# Autodesk Inventor assembly: mecanismo compoleto
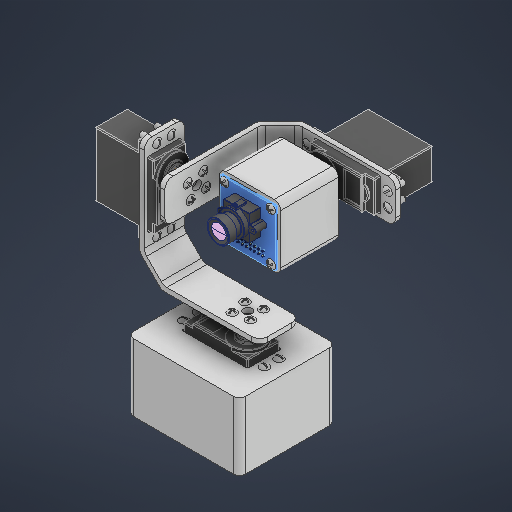
[picture p0: Inventor's stored thumbnail of the model, 512x512]
Saved by Autodesk Inventor 2027.2 (Build 312334000, 334)
## iProperties
Created: 2026-09-12
Part Number: mecanismo compoleto
Document SubType Name: Assembly
Designer: alexa
Project: STAR TRAKCER
Author: alexa
Title: MECANISMO STAR TRACKER
## Documents named in this file (10)
- C:\Users\alexa\tesis-star-tracker\Inventor\Mecanismo_3GDL\Alineacion_R1_20261113\CAD\Gimbal_3GDL_alineado_R1.iam
- C:\Users\alexa\tesis-star-tracker\Inventor\Mecanismo_3GDL\Alineacion_R1_20261113\CAD\base.ipt
- C:\Users\alexa\tesis-star-tracker\Inventor\Mecanismo_3GDL\Alineacion_R1_20261113\CAD\Pieza6.ipt
- C:\Users\alexa\tesis-star-tracker\Inventor\Mecanismo_3GDL\Alineacion_R1_20261113\CAD\Servo MG996R.ipt
- C:\Users\alexa\tesis-star-tracker\Inventor\Mecanismo_3GDL\Alineacion_R1_20261113\CAD\210212-3x5.ipt
- C:\Users\alexa\tesis-star-tracker\Inventor\Mecanismo_3GDL\Alineacion_R1_20261113\CAD\Base_Z.ipt
- C:\Users\alexa\tesis-star-tracker\Inventor\Mecanismo_3GDL\Alineacion_R1_20261113\CAD\Camera OV7670.ipt
- C:\Users\alexa\tesis-star-tracker\Inventor\Mecanismo_3GDL\Alineacion_R1_20261113\CAD\cajita.ipt
- C:\Users\alexa\tesis-star-tracker\Inventor\Mecanismo_3GDL\Alineacion_R1_20261113\CAD\210212-3x10.ipt
- C:\Users\alexa\tesis-star-tracker\Inventor\Mecanismo_3GDL\Alineacion_R1_20261113\CAD\Separador_pitch_0p8_R1.ipt
## Components (40 placed, 9 different names)
1. base:1 — Coincidencia:5, Coincidencia:6, Coincidencia:7, Ángulo:3, Coincidencia:76, Coincidencia:77, Coincidencia:78, Coincidencia:79, Coincidencia:80, Coincidencia:81, Coincidencia:82, Coincidencia:83
2. Pieza6:1 — Nivelación:3, Coincidencia:35, Coincidencia:36, Coincidencia:37, Coincidencia:43, Coincidencia:44
3. Servo MG996R:1 — Coincidencia:5, Coincidencia:6, Coincidencia:7, Coincidencia:36, Coincidencia:37
4. 210212-3x5:1 — Coincidencia:31, Coincidencia:46
5. Base_Z:1 — Nivelación:3, Coincidencia:10, Ángulo:1, Coincidencia:14, Coincidencia:15, Ángulo:3, Coincidencia:31, Coincidencia:32, Coincidencia:33, Coincidencia:34, Coincidencia:35, Coincidencia:43, Coincidencia:44, Coincidencia:45, Coincidencia:46, Coincidencia:47, Coincidencia:48, Coincidencia:84, Coincidencia:85, Coincidencia:86, Coincidencia:87, Coincidencia:92, Coincidencia:93, Coincidencia:94, Coincidencia:95
6. Servo MG996R:2 — Coincidencia:10, Coincidencia:14, Coincidencia:15, Coincidencia:38, Coincidencia:39, Coincidencia:41
7. Base_Z:2 — Ángulo:1, Coincidencia:18, Coincidencia:19, Coincidencia:20, Ángulo:4, Coincidencia:39, Coincidencia:42, Coincidencia:49, Coincidencia:50, Coincidencia:51, Coincidencia:52, Coincidencia:53, Coincidencia:54, Coincidencia:55, Coincidencia:56, Coincidencia:57, Coincidencia:58, Coincidencia:90, Coincidencia:96, Coincidencia:97, Coincidencia:98, Coincidencia:99
8. Pieza6:2 — Coincidencia:38, Coincidencia:41, Coincidencia:42, Coincidencia:49, Coincidencia:50, Separador_origen_1, Separador_origen_2, Separador_origen_3
9. Servo MG996R:3 — Coincidencia:18, Coincidencia:19, Coincidencia:20, Nivelación:7, Coincidencia:40, Coincidencia:88, Coincidencia:89, Coincidencia:91
10. Camera OV7670:1 — Nivelación:8, Coincidencia:26, Coincidencia:27, Coincidencia:72, Coincidencia:73, Coincidencia:74, Coincidencia:75
11. Pieza6:3 — Nivelación:7, Coincidencia:28, Coincidencia:30, Coincidencia:40, Coincidencia:59, Coincidencia:60, Coincidencia:61
12. cajita:1 — Nivelación:8, Coincidencia:26, Coincidencia:27, Coincidencia:28, Coincidencia:30, Ángulo:4, Coincidencia:59, Coincidencia:62, Coincidencia:63, Coincidencia:64, Coincidencia:65, Coincidencia:66, Coincidencia:67, Coincidencia:68, Coincidencia:69, Coincidencia:70, Coincidencia:71
13. 210212-3x5:2 — Coincidencia:32, Coincidencia:48
14. 210212-3x5:3 — Coincidencia:33, Coincidencia:47
15. 210212-3x5:4 — Coincidencia:34, Coincidencia:45
16. 210212-3x5:5 — Coincidencia:71, Coincidencia:75
17. 210212-3x5:6 — Coincidencia:53, Coincidencia:56
18. 210212-3x5:7 — Coincidencia:52, Coincidencia:55
19. 210212-3x5:8 — Coincidencia:51, Coincidencia:58
20. 210212-3x5:9 — Coincidencia:54, Coincidencia:57
21. 210212-3x5:10 — Coincidencia:62, Coincidencia:66
22. 210212-3x5:11 — Coincidencia:61, Coincidencia:65
23. 210212-3x5:12 — Coincidencia:63, Coincidencia:64
24. 210212-3x5:13 — Coincidencia:60, Coincidencia:67
25. 210212-3x5:14 — Coincidencia:68, Coincidencia:74
26. 210212-3x5:15 — Coincidencia:69, Coincidencia:73
27. 210212-3x5:16 — Coincidencia:70, Coincidencia:72
28. 210212-3x10:1 — Coincidencia:76, Coincidencia:81
29. 210212-3x10:2 — Coincidencia:79, Coincidencia:83
30. 210212-3x10:3 — Coincidencia:77, Coincidencia:80
31. 210212-3x10:4 — Coincidencia:78, Coincidencia:82
32. 210212-3x10:5 — Coincidencia:85, Coincidencia:93
33. 210212-3x10:6 — Coincidencia:84, Coincidencia:92
34. 210212-3x10:7 — Coincidencia:87, Coincidencia:95
35. 210212-3x10:8 — Coincidencia:86, Coincidencia:94
36. 210212-3x10:9 — Coincidencia:89, Coincidencia:99
37. 210212-3x10:10 — Coincidencia:90, Coincidencia:96
38. 210212-3x10:11 — Coincidencia:91, Coincidencia:97
39. 210212-3x10:12 — Coincidencia:88, Coincidencia:98
40. Separador pitch 0.8 mm — Separador_origen_1, Separador_origen_2, Separador_origen_3
## Relationships (91: Mate 82, Flush 6, Angle 3)
- Coincidencia:5 [Mate] (0.5 mm): base:1 ↔ Servo MG996R:1
- Coincidencia:6 [Mate]: base:1 ↔ Servo MG996R:1
- Coincidencia:7 [Mate]: base:1 ↔ Servo MG996R:1
- Nivelación:3 [Flush]: Pieza6:1 ↔ Base_Z:1
- Coincidencia:10 [Mate] (0.5 mm): Base_Z:1 ↔ Servo MG996R:2
- Ángulo:1 [Angle] (0 deg): Base_Z:1 ↔ Base_Z:2
- Coincidencia:14 [Mate]: Base_Z:1 ↔ Servo MG996R:2
- Coincidencia:15 [Mate]: Base_Z:1 ↔ Servo MG996R:2
- Coincidencia:18 [Mate] (0.5 mm): Base_Z:2 ↔ Servo MG996R:3
- Coincidencia:19 [Mate]: Base_Z:2 ↔ Servo MG996R:3
- Coincidencia:20 [Mate]: Base_Z:2 ↔ Servo MG996R:3
- Ángulo:3 [Angle] (0 deg): base:1 ↔ Base_Z:1
- Nivelación:7 [Flush]: Servo MG996R:3 ↔ Pieza6:3
- Nivelación:8 [Flush]: Camera OV7670:1 ↔ cajita:1
- Coincidencia:26 [Mate]: Camera OV7670:1 ↔ cajita:1
- Coincidencia:27 [Mate]: Camera OV7670:1 ↔ cajita:1
- Coincidencia:28 [Mate]: Pieza6:3 ↔ cajita:1
- Coincidencia:30 [Mate]: Pieza6:3 ↔ cajita:1
- Ángulo:4 [Angle] (0 deg): Base_Z:2 ↔ cajita:1
- Coincidencia:31 [Mate]: 210212-3x5:1 ↔ Base_Z:1
- Coincidencia:32 [Mate]: Base_Z:1 ↔ 210212-3x5:2
- Coincidencia:33 [Mate]: Base_Z:1 ↔ 210212-3x5:3
- Coincidencia:34 [Mate]: Base_Z:1 ↔ 210212-3x5:4
- Coincidencia:35 [Mate]: Pieza6:1 ↔ Base_Z:1
- Coincidencia:36 [Mate]: Pieza6:1 ↔ Servo MG996R:1
- Coincidencia:37 [Mate]: Pieza6:1 ↔ Servo MG996R:1
- Coincidencia:38 [Mate]: Servo MG996R:2 ↔ Pieza6:2
- Coincidencia:39 [Mate]: Servo MG996R:2 ↔ Base_Z:2
- Coincidencia:40 [Mate]: Servo MG996R:3 ↔ Pieza6:3
- Coincidencia:41 [Mate]: Servo MG996R:2 ↔ Pieza6:2
- Coincidencia:42 [Mate] (0.8 mm): Base_Z:2 ↔ Pieza6:2
- Coincidencia:43 [Mate]: Pieza6:1 ↔ Base_Z:1
- Coincidencia:44 [Mate]: Pieza6:1 ↔ Base_Z:1
- Coincidencia:45 [Mate]: Base_Z:1 ↔ 210212-3x5:4
- Coincidencia:46 [Mate]: 210212-3x5:1 ↔ Base_Z:1
- Coincidencia:47 [Mate]: Base_Z:1 ↔ 210212-3x5:3
- Coincidencia:48 [Mate]: Base_Z:1 ↔ 210212-3x5:2
- Coincidencia:49 [Mate]: Base_Z:2 ↔ Pieza6:2
- Coincidencia:50 [Mate]: Base_Z:2 ↔ Pieza6:2
- Coincidencia:51 [Mate]: Base_Z:2 ↔ 210212-3x5:8
- Coincidencia:52 [Mate]: Base_Z:2 ↔ 210212-3x5:7
- Coincidencia:53 [Mate]: Base_Z:2 ↔ 210212-3x5:6
- Coincidencia:54 [Mate]: Base_Z:2 ↔ 210212-3x5:9
- Coincidencia:55 [Mate]: Base_Z:2 ↔ 210212-3x5:7
- Coincidencia:56 [Mate]: Base_Z:2 ↔ 210212-3x5:6
- Coincidencia:57 [Mate]: Base_Z:2 ↔ 210212-3x5:9
- Coincidencia:58 [Mate]: Base_Z:2 ↔ 210212-3x5:8
- Coincidencia:59 [Mate]: Pieza6:3 ↔ cajita:1
- Coincidencia:60 [Mate]: Pieza6:3 ↔ 210212-3x5:13
- Coincidencia:61 [Mate]: Pieza6:3 ↔ 210212-3x5:11
- Coincidencia:62 [Mate]: cajita:1 ↔ 210212-3x5:10
- Coincidencia:63 [Mate]: cajita:1 ↔ 210212-3x5:12
- Coincidencia:64 [Mate]: cajita:1 ↔ 210212-3x5:12
- Coincidencia:65 [Mate]: cajita:1 ↔ 210212-3x5:11
- Coincidencia:66 [Mate]: cajita:1 ↔ 210212-3x5:10
- Coincidencia:67 [Mate]: cajita:1 ↔ 210212-3x5:13
- Coincidencia:68 [Mate]: cajita:1 ↔ 210212-3x5:14
- Coincidencia:69 [Mate]: cajita:1 ↔ 210212-3x5:15
- Coincidencia:70 [Mate]: cajita:1 ↔ 210212-3x5:16
- Coincidencia:71 [Mate]: cajita:1 ↔ 210212-3x5:5
- Coincidencia:72 [Mate]: Camera OV7670:1 ↔ 210212-3x5:16
- Coincidencia:73 [Mate]: Camera OV7670:1 ↔ 210212-3x5:15
- Coincidencia:74 [Mate]: Camera OV7670:1 ↔ 210212-3x5:14
- Coincidencia:75 [Mate]: Camera OV7670:1 ↔ 210212-3x5:5
- Coincidencia:76 [Mate]: base:1 ↔ 210212-3x10:1
- Coincidencia:77 [Mate]: base:1 ↔ 210212-3x10:3
- Coincidencia:78 [Mate]: base:1 ↔ 210212-3x10:4
- Coincidencia:79 [Mate]: base:1 ↔ 210212-3x10:2
- Coincidencia:80 [Mate]: base:1 ↔ 210212-3x10:3
- Coincidencia:81 [Mate]: base:1 ↔ 210212-3x10:1
- Coincidencia:82 [Mate]: base:1 ↔ 210212-3x10:4
- Coincidencia:83 [Mate]: base:1 ↔ 210212-3x10:2
- Coincidencia:84 [Mate]: Base_Z:1 ↔ 210212-3x10:6
- Coincidencia:85 [Mate]: Base_Z:1 ↔ 210212-3x10:5
- Coincidencia:86 [Mate]: Base_Z:1 ↔ 210212-3x10:8
- Coincidencia:87 [Mate]: Base_Z:1 ↔ 210212-3x10:7
- Coincidencia:88 [Mate]: Servo MG996R:3 ↔ 210212-3x10:12
- Coincidencia:89 [Mate]: Servo MG996R:3 ↔ 210212-3x10:9
- Coincidencia:90 [Mate]: Base_Z:2 ↔ 210212-3x10:10
- Coincidencia:91 [Mate]: Servo MG996R:3 ↔ 210212-3x10:11
- Coincidencia:92 [Mate]: Base_Z:1 ↔ 210212-3x10:6
- Coincidencia:93 [Mate]: Base_Z:1 ↔ 210212-3x10:5
- Coincidencia:94 [Mate]: Base_Z:1 ↔ 210212-3x10:8
- Coincidencia:95 [Mate]: Base_Z:1 ↔ 210212-3x10:7
- Coincidencia:96 [Mate]: Base_Z:2 ↔ 210212-3x10:10
- Coincidencia:97 [Mate]: Base_Z:2 ↔ 210212-3x10:11
- Coincidencia:98 [Mate]: Base_Z:2 ↔ 210212-3x10:12
- Coincidencia:99 [Mate]: Base_Z:2 ↔ 210212-3x10:9
- Separador_origen_1 [Flush]: Pieza6:2 ↔ Separador pitch 0.8 mm
- Separador_origen_2 [Flush]: Pieza6:2 ↔ Separador pitch 0.8 mm
- Separador_origen_3 [Flush]: Pieza6:2 ↔ Separador pitch 0.8 mm
